# Autodesk Inventor assembly: Motor asm
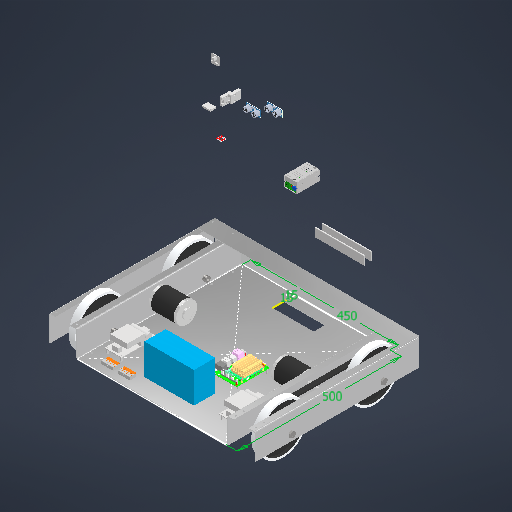
[picture p0: Inventor's stored thumbnail of the model, 512x512]
Saved by Autodesk Inventor 2026.2 (Build 302298010, 298A)
## iProperties
Created: 2026-05-25
Part Number: Motor asm
Document SubType Name: Assembly
Designer: User
Author: User
## Documents named in this file (25)
- D:\Autodesk Invento Pro Work\Honours Project\Parts\Motor asm.iam
- D:\Autodesk Invento Pro Work\Honours Project\Parts\Base Plate.ipt
- D:\Autodesk Invento Pro Work\Honours Project\Parts\S_Bend.ipt
- D:\Autodesk Invento Pro Work\Honours Project\Parts\L_Bend.ipt
- D:\Autodesk Invento Pro Work\Honours Project\Parts\C_Bend.ipt
- D:\Autodesk Invento Pro Work\Honours Project\Parts\Wheel.ipt
- D:\Autodesk Invento Pro Work\Honours Project\Parts\217-3371-STEP.ipt
- D:\Autodesk Invento Pro Work\Honours Project\Parts\Wheel_Axel.ipt
- C:\Users\User\OneDrive\文档\Inventor\Content Center Files\R2026\en-US\M\M 10x90.ipt
- C:\Users\User\OneDrive\文档\Inventor\Content Center Files\R2026\en-US\AS 1112 (4)\AS 1112 - M10(2).ipt
- D:\Autodesk Invento Pro Work\Honours Project\Parts\Timing Belt (model only).ipt
- D:\Autodesk Invento Pro Work\Honours Project\Parts\Jetson_Nano_Dev_Kit_3D_b01.iam
- D:\Autodesk Invento Pro Work\Honours Project\Parts\Battery.ipt
- D:\Autodesk Invento Pro Work\Honours Project\Parts\221-615.ipt
- D:\Autodesk Invento Pro Work\Honours Project\Parts\Brush Sweeper.ipt
- D:\Autodesk Invento Pro Work\Honours Project\Parts\VRM_part.ipt
- D:\Autodesk Invento Pro Work\Honours Project\Parts\BOB-12009.ipt
- D:\Autodesk Invento Pro Work\Honours Project\Parts\DFR0946.ipt
- D:\Autodesk Invento Pro Work\Honours Project\Parts\H Bridge.ipt
- D:\Autodesk Invento Pro Work\Honours Project\Parts\camera.ipt
- D:\Autodesk Invento Pro Work\Honours Project\Parts\hall effect sensor.ipt
- D:\Autodesk Invento Pro Work\Honours Project\Parts\IMU.ipt
- D:\Autodesk Invento Pro Work\Honours Project\Parts\HC-SR04.iam
- D:\Autodesk Invento Pro Work\Honours Project\Parts\Screw Peg_2.2.ipt
- D:\Autodesk Invento Pro Work\Honours Project\Parts\Screw Peg.ipt
## Components (57 placed, 24 different names)
1. Base Plate:1 — Insert:1, Flush:1, Flush:2, Flush:3, Flush:4, Flush:5, Flush:6, Mate:31, Mate:32, Mate:33, Mate:34, Mate:35, Mate:36, Mate:37, Mate:38, Mate:41, Mate:42, Mate:43, Mate:44, Mate:45
2. C_Bend:1 — Mate:7, Mate:9, Mate:15, Mate:24
3. S_Bend:2 — Insert:1, Mate:7, Mate:10, Mate:11, Mate:16, Mate:17, Insert:2, Insert:3
4. L_Bend:1 — Mate:15, Mate:18, Mate:22
5. 217-3371-STEP:2 — Mate:10
6. Wheel:1 — Mate:19
7. Wheel:2 — Mate:6
8. Wheel_Axel:1 — Mate:6, Insert:2, Mate:23
9. Wheel_Axel:2 — Mate:19, Insert:3
10. Timing Belt (model only):2 — Mate:23
11. M 10x90:1 — Mate:16
12. M 10x90:2 — Mate:17
13. AS 1112 (4) - Metric M10:1 — Mate:18
14. AS 1112 (4) - Metric M10:2 — Mate:22
15. C_Bend:2 — Mate:11
16. L_Bend:2 — Mate:9, Mate:29, Mate:30
17. 217-3371-STEP:1 — Mate:25
18. AS 1112 (4) - Metric M10:3 — Mate:29
19. AS 1112 (4) - Metric M10:4 — Mate:30
20. Wheel_Axel:3 — Mate:20, Insert:5
21. Wheel_Axel:4 — Mate:21, Insert:4, Mate:28
22. Wheel:3 — Mate:21
23. Wheel:4 — Mate:20
24. Timing Belt (model only):1 — Mate:28
25. S_Bend:3 — Mate:24, Mate:25, Mate:26, Mate:27, Insert:4, Insert:5
26. M 10x90:3 — Mate:26
27. M 10x90:4 — Mate:27
28. Battery:1 — Flush:1, Flush:2
29. 221-615:1 — Flush:5, Flush:6
30. 221-615:2 — Flush:3, Flush:4
31. Brush Sweeper:1
32. Brush Sweeper:2
33. BOB-12009:1
34. BOB-12009:2
35. DFR0946:1
36. H Bridge:1 — Mate:40
37. H Bridge:2 — Mate:39
38. camera:1
39. hall effect sensor:2
40. hall effect sensor:3
41. IMU:1
42. HC-SR04:1 [sub-assembly]
43. HC-SR04:2 [sub-assembly]
44. Screw Peg_2.2:1 — Mate:33
45. Screw Peg_2.2:2 — Mate:35
46. Screw Peg_2.2:3 — Mate:32, Mate:40
47. Screw Peg_2.2:4 — Mate:36
48. Screw Peg_2.2:5 — Mate:37, Mate:39
49. Screw Peg_2.2:6 — Mate:38
50. Screw Peg_2.2:7 — Mate:31
51. Screw Peg_2.2:8 — Mate:34
52. VRM_part:1 — Mate:41
53. Jetson_Nano_Dev_Kit_3D_b01:1 [sub-assembly] — Mate:46
54. Screw Peg:1 — Mate:42, Mate:46
55. Screw Peg:2 — Mate:43
56. Screw Peg:3 — Mate:44
57. Screw Peg:4 — Mate:45
## Relationships (48: Mate 37, Flush 6, Insert 5)
- Insert:1: Base Plate:1 ↔ S_Bend:2
- Mate:6: Wheel:2 ↔ Wheel_Axel:1
- Mate:7: C_Bend:1 ↔ S_Bend:2
- Mate:9: C_Bend:1 ↔ L_Bend:2
- Mate:10: S_Bend:2 ↔ 217-3371-STEP:2
- Mate:11: S_Bend:2 ↔ C_Bend:2
- Mate:15: C_Bend:1 ↔ L_Bend:1
- Mate:16: S_Bend:2 ↔ M 10x90:1
- Mate:17: S_Bend:2 ↔ M 10x90:2
- Mate:18: L_Bend:1 ↔ AS 1112 (4) - Metric M10:1
- Mate:19: Wheel:1 ↔ Wheel_Axel:2
- Mate:20: Wheel_Axel:3 ↔ Wheel:4
- Mate:21: Wheel_Axel:4 ↔ Wheel:3
- Insert:2 (10 mm): S_Bend:2 ↔ Wheel_Axel:1
- Insert:3 (10 mm): S_Bend:2 ↔ Wheel_Axel:2
- Mate:22: L_Bend:1 ↔ AS 1112 (4) - Metric M10:2
- Mate:23: Wheel_Axel:1 ↔ Timing Belt (model only):2
- Mate:24: C_Bend:1 ↔ S_Bend:3
- Mate:25: 217-3371-STEP:1 ↔ S_Bend:3
- Mate:26: S_Bend:3 ↔ M 10x90:3
- Mate:27: S_Bend:3 ↔ M 10x90:4
- Insert:4 (10 mm): Wheel_Axel:4 ↔ S_Bend:3
- Insert:5 (10 mm): Wheel_Axel:3 ↔ S_Bend:3
- Mate:28: Wheel_Axel:4 ↔ Timing Belt (model only):1
- Mate:29: L_Bend:2 ↔ AS 1112 (4) - Metric M10:3
- Mate:30: L_Bend:2 ↔ AS 1112 (4) - Metric M10:4
- Flush:1 (149.5 mm): Base Plate:1 ↔ Battery:1
- Flush:2 (52 mm): Base Plate:1 ↔ Battery:1
- Flush:3 (100 mm): Base Plate:1 ↔ 221-615:2
- Flush:4 (20 mm): Base Plate:1 ↔ 221-615:2
- Flush:5 (20 mm): Base Plate:1 ↔ 221-615:1
- Flush:6 (50 mm): Base Plate:1 ↔ 221-615:1
- Mate:31: Base Plate:1 ↔ Screw Peg_2.2:7
- Mate:32: Base Plate:1 ↔ Screw Peg_2.2:3
- Mate:33: Base Plate:1 ↔ Screw Peg_2.2:1
- Mate:34: Base Plate:1 ↔ Screw Peg_2.2:8
- Mate:35: Base Plate:1 ↔ Screw Peg_2.2:2
- Mate:36: Base Plate:1 ↔ Screw Peg_2.2:4
- Mate:37: Base Plate:1 ↔ Screw Peg_2.2:5
- Mate:38: Base Plate:1 ↔ Screw Peg_2.2:6
- Mate:39: H Bridge:2 ↔ Screw Peg_2.2:5
- Mate:40: H Bridge:1 ↔ Screw Peg_2.2:3
- Mate:41: Base Plate:1 ↔ VRM_part:1
- Mate:42: Base Plate:1 ↔ Screw Peg:1
- Mate:43: Base Plate:1 ↔ Screw Peg:2
- Mate:44: Base Plate:1 ↔ Screw Peg:3
- Mate:45: Base Plate:1 ↔ Screw Peg:4
- Mate:46: Jetson_Nano_Dev_Kit_3D_b01:1 ↔ Screw Peg:1
